# Autodesk Inventor assembly: Container_ASM
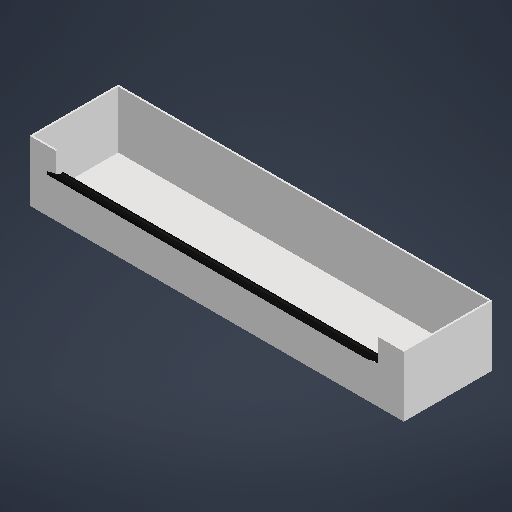
[picture p0: Inventor's stored thumbnail of the model, 512x512]
Saved by Autodesk Inventor 2026.2 (Build 302298010, 298A)
## iProperties
Created: 2026-10-11
Part Number: Container_ASM
Document SubType Name: Assembly
Designer: User
Author: User
## Documents named in this file (3)
- D:\Autodesk Invento Pro Work\Honours Project\Parts\Container_ASM.iam
- D:\Autodesk Invento Pro Work\Honours Project\Parts\Container_section.ipt
- D:\Autodesk Invento Pro Work\Honours Project\Parts\Rubber blade.ipt
## Components (2 placed, 2 different names)
1. Container_section:1 — Mate:1
2. Rubber blade:1 — Mate:1
## Relationships (1: Mate 1)
- Mate:1 (0.5 mm): Container_section:1 ↔ Rubber blade:1
